# Autodesk Inventor assembly: Ensamblaje2
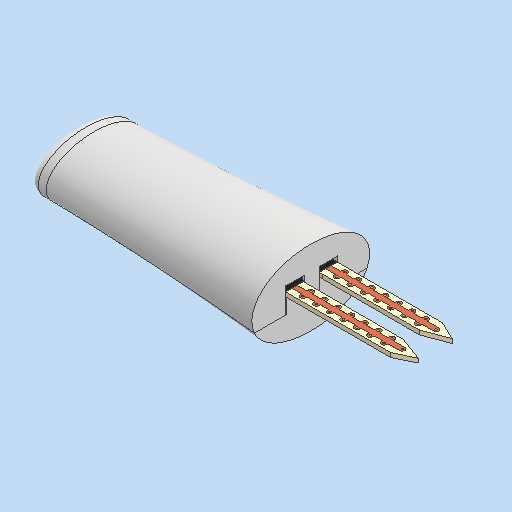
[picture p0: Inventor's stored thumbnail of the model, 512x512]
Saved by Autodesk Inventor 2026.3 (Build 303398000, 398)
## iProperties
Created: 2026-11-15
Part Number: Ensamblaje2
Document SubType Name: Assembly
Designer: Hp
Author: Hp
## Documents named in this file (6)
- C:\Users\Hp\Documents\GitHub\case-moss\stl\Ensamblaje2.iam
- C:\Users\Hp\Documents\GitHub\case-moss\modelos3d\3x7cm\3x7cm.ipt
- C:\Users\Hp\Documents\GitHub\case-moss\modelos3d\soil-sensor\soil-sensor.ipt
- C:\Users\Hp\Documents\GitHub\case-moss\modelos3d\soil-moisture-sensor-probe\soil-moisture-sensor-probe.ipt
- C:\Users\Hp\Documents\GitHub\case-moss\stl\case-sensor.ipt
- C:\Users\Hp\Documents\GitHub\case-moss\stl\Pieza8.ipt
## Components (5 placed, 5 different names)
1. 3x7cm:1 — Coincidencia:1, Tangente:1, Tangente:2, Tangente:3, Nivelación:4
2. soil-sensor:1 — Coincidencia:1, Tangente:1, Tangente:2, Tangente:3, Nivelación:1, Nivelación:2
3. soil-moisture-sensor-probe:1 — Nivelación:1, Nivelación:2, Nivelación:3
4. case-sensor:1 — Nivelación:3, Nivelación:5, Nivelación:6, Nivelación:7, Nivelación:8, Nivelación:9
5. Pieza8:1 — Nivelación:6, Nivelación:7, Nivelación:8, Nivelación:9
## Relationships (13: Flush 9, Tangent 3, Mate 1)
- Coincidencia:1 [Mate]: 3x7cm:1 ↔ soil-sensor:1
- Tangente:1: 3x7cm:1 ↔ soil-sensor:1
- Tangente:2: 3x7cm:1 ↔ soil-sensor:1
- Tangente:3: 3x7cm:1 ↔ soil-sensor:1
- Nivelación:1 [Flush] (1 mm): soil-sensor:1 ↔ soil-moisture-sensor-probe:1
- Nivelación:2 [Flush] (0.1 mm): soil-sensor:1 ↔ soil-moisture-sensor-probe:1
- Nivelación:3 [Flush]: soil-moisture-sensor-probe:1 ↔ case-sensor:1
- Nivelación:4 [Flush] (4 mm): 3x7cm:1
- Nivelación:5 [Flush]: case-sensor:1
- Nivelación:6 [Flush]: case-sensor:1 ↔ Pieza8:1
- Nivelación:7 [Flush]: case-sensor:1 ↔ Pieza8:1
- Nivelación:8 [Flush] (-36.5 mm): case-sensor:1 ↔ Pieza8:1
- Nivelación:9 [Flush]: case-sensor:1 ↔ Pieza8:1
